# Autodesk Inventor assembly: ENSAMBLE3
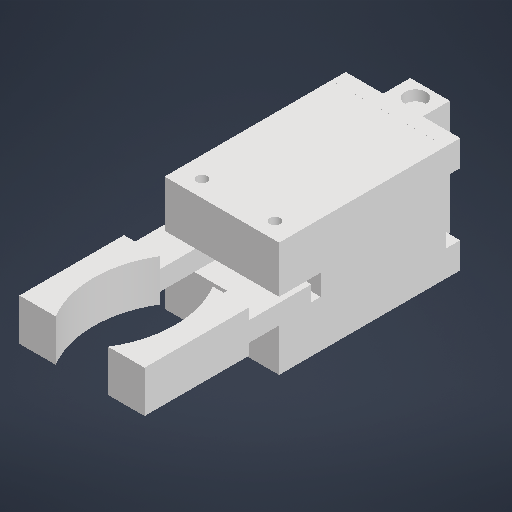
[picture p0: Inventor's stored thumbnail of the model, 512x512]
Saved by Autodesk Inventor 2027.1 (Build 311270010, 270A)
## iProperties
Created: 2026-11-03
Part Number: ENSAMBLE3
Document SubType Name: Assembly
Designer: MANGEL
Author: MANGEL
## Documents named in this file (4)
- C:\Users\MANGEL\Desktop\Brazo 4GL\ENSAMBLE3.iam
- C:\Users\MANGEL\Desktop\Brazo 4GL\pinza.ipt
- C:\Users\MANGEL\Desktop\Brazo 4GL\soportePinza.ipt
- C:\Users\MANGEL\Desktop\Brazo 4GL\trasePinza.ipt
## Components (4 placed, 3 different names)
1. pinza:1 — Insertar:2
2. pinza:2 — Insertar:1
3. soportePinza:1 — Insertar:1, Insertar:2, Coincidencia:1, Nivelación:1, Nivelación:2
4. trasePinza:1 — Coincidencia:1, Nivelación:1, Nivelación:2
## Relationships (5: Insert 2, Flush 2, Mate 1)
- Insertar:1: pinza:2 ↔ soportePinza:1
- Insertar:2: pinza:1 ↔ soportePinza:1
- Coincidencia:1 [Mate]: soportePinza:1 ↔ trasePinza:1
- Nivelación:1 [Flush]: soportePinza:1 ↔ trasePinza:1
- Nivelación:2 [Flush]: soportePinza:1 ↔ trasePinza:1
